# Autodesk Inventor assembly: PUMA_X
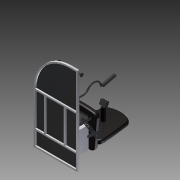
[picture p0: Inventor's stored thumbnail of the model, 180x180]
Saved by Autodesk Inventor 2015 (Build 190159000, 159)
## iProperties
Created: 2022-11-04
Part Number: PUMA_X
Document SubType Name: Assembly
Designer: Pavel Brodský
Author: Pavel Brodský
## Documents named in this file (16)
- C:\Users\brodh\Dropbox\FS_utts\heli_pro_flight_trainer\ProFlightTrainer\PUMA_X.iam
- C:\Users\brodh\Dropbox\FS_utts\heli_pro_flight_trainer\ProFlightTrainer\base.ipt
- C:\Users\brodh\Dropbox\FS_utts\heli_pro_flight_trainer\ProFlightTrainer\fwd_support.ipt
- C:\Users\brodh\Dropbox\FS_utts\heli_pro_flight_trainer\ProFlightTrainer\pedal.ipt
- C:\Users\brodh\Dropbox\FS_utts\heli_pro_flight_trainer\ProFlightTrainer\central_part.ipt
- C:\Users\brodh\Dropbox\FS_utts\heli_pro_flight_trainer\ProFlightTrainer\foot_plate.ipt
- C:\Users\brodh\Dropbox\FS_utts\heli_pro_flight_trainer\ProFlightTrainer\cyclic_kloub.ipt
- C:\Users\brodh\Dropbox\FS_utts\heli_pro_flight_trainer\ProFlightTrainer\cyclic_base.ipt
- C:\Users\brodh\Dropbox\FS_utts\heli_pro_flight_trainer\ProFlightTrainer\cyclic.ipt
- C:\Users\brodh\Dropbox\FS_utts\heli_pro_flight_trainer\ProFlightTrainer\collecive_support_1.ipt
- C:\Users\brodh\Dropbox\FS_utts\heli_pro_flight_trainer\ProFlightTrainer\collecive_support_2.ipt
- C:\Users\brodh\Dropbox\FS_utts\heli_pro_flight_trainer\ProFlightTrainer\collective.ipt
- C:\Users\brodh\Dropbox\FS_utts\heli_pro_flight_trainer\ProFlightTrainer\floor.ipt
- C:\Users\brodh\Dropbox\FS_utts\heli_pro_flight_trainer\ProFlightTrainer\seat0.ipt
- C:\Users\brodh\Dropbox\FS_utts\heli_pro_flight_trainer\ProFlightTrainer\seat1.ipt
- C:\Users\brodh\Dropbox\FS_utts\heli_pro_flight_trainer\ProFlightTrainer\seat2.ipt
## Components (16 placed, 15 different names)
1. base:1 — Proti sobě:1, Proti sobě:2, Proti sobě:3, Proti sobě:4, Proti sobě:5, Proti sobě:6, Proti sobě:7, Úhel:1, Proti sobě:10, Proti sobě:11, Proti sobě:12, Proti sobě:13, Proti sobě:14, Proti sobě:18, Úhel:2, Úhel:5, Úhel:6
2. fwd_support:1 — Proti sobě:1, Proti sobě:2, Proti sobě:3, Stejný směr:1
3. pedal:1 — Proti sobě:4, Proti sobě:5, Proti sobě:8, Proti sobě:9, Úhel:1
4. pedal:2 — Proti sobě:6, Proti sobě:7, Proti sobě:8, Proti sobě:9
5. central_part:1 — Proti sobě:10, Proti sobě:11, Proti sobě:12, Proti sobě:13, Proti sobě:14, Proti sobě:15, Proti sobě:16, Proti sobě:17, Proti sobě:19, Proti sobě:20
6. foot_plate:1 — Proti sobě:15, Proti sobě:16, Proti sobě:17, Proti sobě:18, Proti sobě:27, Úhel:3, Proti sobě:28, Proti sobě:29, Úhel:4, Proti sobě:35, Stejný směr:2
7. cyclic_kloub:1 — Proti sobě:19, Proti sobě:20, Proti sobě:21, Proti sobě:22
8. cyclic_base:1 — Proti sobě:21, Proti sobě:22, Proti sobě:23, Proti sobě:24, Proti sobě:25, Proti sobě:26, Úhel:2
9. cyclic:1 — Proti sobě:23, Proti sobě:24, Proti sobě:25, Proti sobě:26
10. collecive_support_1:1 — Proti sobě:27, Úhel:3, Proti sobě:28, Proti sobě:29, Proti sobě:30, Proti sobě:31, Proti sobě:32
11. collecive_support_2:1 — Proti sobě:30, Úhel:4, Proti sobě:31, Proti sobě:32, Proti sobě:33, Proti sobě:34
12. collective:1 — Proti sobě:33, Proti sobě:34, Úhel:5
13. floor:1 — Proti sobě:35, Úhel:6, Stejný směr:1, Stejný směr:2, Proti sobě:39, Stejný směr:6, Stejný směr:7
14. seat0:1 — Proti sobě:36, Stejný směr:3, Proti sobě:38, Stejný směr:4, Stejný směr:5, Proti sobě:39, Stejný směr:6, Stejný směr:7
15. seat1:1 — Proti sobě:36, Proti sobě:37, Proti sobě:38, Stejný směr:5
16. seat2:1 — Proti sobě:37, Stejný směr:3, Stejný směr:4
## Relationships (52: Mate 39, Flush 7, Angle 6)
- Proti sobě:1 [Mate]: base:1 ↔ fwd_support:1
- Proti sobě:2 [Mate]: base:1 ↔ fwd_support:1
- Proti sobě:3 [Mate]: base:1 ↔ fwd_support:1
- Proti sobě:4 [Mate]: base:1 ↔ pedal:1
- Proti sobě:5 [Mate]: base:1 ↔ pedal:1
- Proti sobě:6 [Mate]: base:1 ↔ pedal:2
- Proti sobě:7 [Mate]: base:1 ↔ pedal:2
- Proti sobě:8 [Mate]: pedal:1 ↔ pedal:2
- Proti sobě:9 [Mate]: pedal:1 ↔ pedal:2
- Úhel:1 [Angle] (70 deg): base:1 ↔ pedal:1
- Proti sobě:10 [Mate]: base:1 ↔ central_part:1
- Proti sobě:11 [Mate]: base:1 ↔ central_part:1
- Proti sobě:12 [Mate] (2.5 mm): base:1 ↔ central_part:1
- Proti sobě:13 [Mate] (2.5 mm): base:1 ↔ central_part:1
- Proti sobě:14 [Mate] (45 mm): base:1 ↔ central_part:1
- Proti sobě:15 [Mate]: central_part:1 ↔ foot_plate:1
- Proti sobě:16 [Mate] (2.5 mm): central_part:1 ↔ foot_plate:1
- Proti sobě:17 [Mate] (2.5 mm): central_part:1 ↔ foot_plate:1
- Proti sobě:18 [Mate] (35 mm): base:1 ↔ foot_plate:1
- Proti sobě:19 [Mate]: central_part:1 ↔ cyclic_kloub:1
- Proti sobě:20 [Mate] (9 mm): central_part:1 ↔ cyclic_kloub:1
- Proti sobě:21 [Mate]: cyclic_kloub:1 ↔ cyclic_base:1
- Proti sobě:22 [Mate]: cyclic_kloub:1 ↔ cyclic_base:1
- Proti sobě:23 [Mate] (9 mm): cyclic_base:1 ↔ cyclic:1
- Proti sobě:24 [Mate] (2.5 mm): cyclic_base:1 ↔ cyclic:1
- Proti sobě:25 [Mate] (2.5 mm): cyclic_base:1 ↔ cyclic:1
- Proti sobě:26 [Mate] (-8 mm): cyclic_base:1 ↔ cyclic:1
- Úhel:2 [Angle] (90 deg): base:1 ↔ cyclic_base:1
- Proti sobě:27 [Mate]: foot_plate:1 ↔ collecive_support_1:1
- Úhel:3 [Angle] (238 deg): foot_plate:1 ↔ collecive_support_1:1
- Proti sobě:28 [Mate] (-27 mm): foot_plate:1 ↔ collecive_support_1:1
- Proti sobě:29 [Mate] (-34 mm): foot_plate:1 ↔ collecive_support_1:1
- Proti sobě:30 [Mate]: collecive_support_1:1 ↔ collecive_support_2:1
- Úhel:4 [Angle] (9 deg): foot_plate:1 ↔ collecive_support_2:1
- Proti sobě:31 [Mate] (-50 mm): collecive_support_1:1 ↔ collecive_support_2:1
- Proti sobě:32 [Mate] (-50 mm): collecive_support_1:1 ↔ collecive_support_2:1
- Proti sobě:33 [Mate]: collecive_support_2:1 ↔ collective:1
- Proti sobě:34 [Mate]: collecive_support_2:1 ↔ collective:1
- Úhel:5 [Angle] (0 deg): base:1 ↔ collective:1
- Proti sobě:35 [Mate] (5 mm): foot_plate:1 ↔ floor:1
- Úhel:6 [Angle] (0 deg): base:1 ↔ floor:1
- Stejný směr:1 [Flush] (200 mm): fwd_support:1 ↔ floor:1
- Stejný směr:2 [Flush] (20 mm): foot_plate:1 ↔ floor:1
- Proti sobě:36 [Mate]: seat0:1 ↔ seat1:1
- Proti sobě:37 [Mate]: seat1:1 ↔ seat2:1
- Stejný směr:3 [Flush] (125 mm): seat0:1 ↔ seat2:1
- Proti sobě:38 [Mate] (-150 mm): seat0:1 ↔ seat1:1
- Stejný směr:4 [Flush]: seat0:1 ↔ seat2:1
- Stejný směr:5 [Flush]: seat0:1 ↔ seat1:1
- Proti sobě:39 [Mate]: floor:1 ↔ seat0:1
- Stejný směr:6 [Flush] (15 mm): floor:1 ↔ seat0:1
- Stejný směr:7 [Flush] (170 mm): floor:1 ↔ seat0:1
